# Autodesk Inventor assembly: WAS-PCB
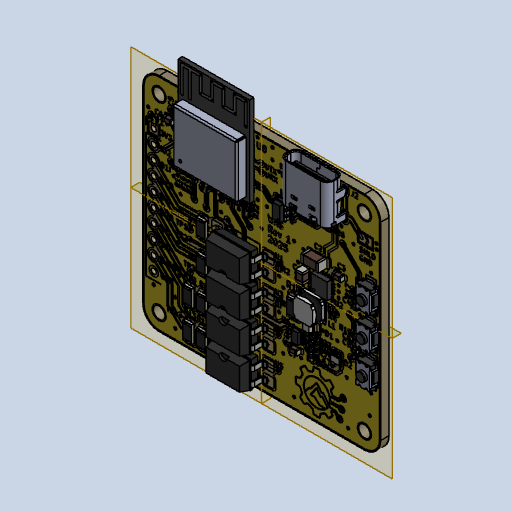
[picture p0: Inventor's stored thumbnail of the model, 512x512]
Saved by Autodesk Inventor 2027.1 (Build 311270010, 270A)
## iProperties
Company: Kicad
Created: 2025-09-30
Part Number: WAS-PCB
Description: KiCad electronic assembly
Document SubType Name: Assembly
Designer: K. Paulsen
Authority: Unknown
Sending System: KiCad to STEP converter
Preprocessor: Open CASCADE STEP processor 7.9
Title: WAS-PCB.step
Author: Pcbnew
## Documents named in this file (23)
- C:\repo\WAS\CAD\WAS-PCB\WAS-PCB\WAS-PCB.iam
- C:\repo\WAS\CAD\WAS-PCB\WAS-PCB\C_1206_3216Metric.ipt
- C:\repo\WAS\CAD\WAS-PCB\WAS-PCB\R_0402_1005Metric.ipt
- C:\repo\WAS\CAD\WAS-PCB\WAS-PCB\TYPE-C-31-M-12.iam
- C:\repo\WAS\CAD\WAS-PCB\WAS-PCB\SMDIP-4_W9.53mm.ipt
- C:\repo\WAS\CAD\WAS-PCB\WAS-PCB\C_0603_1608Metric.ipt
- C:\repo\WAS\CAD\WAS-PCB\WAS-PCB\APTF1616LSEEZGKQBKC.ipt
- C:\repo\WAS\CAD\WAS-PCB\WAS-PCB\TPS62152RGTR.ipt
- C:\repo\WAS\CAD\WAS-PCB\WAS-PCB\ESP32-C3-MINI-1-N4.ipt
- C:\repo\WAS\CAD\WAS-PCB\WAS-PCB\C_0402_1005Metric.ipt
- C:\repo\WAS\CAD\WAS-PCB\WAS-PCB\TS-1088-AR02016.ipt
- C:\repo\WAS\CAD\WAS-PCB\WAS-PCB\R_1206_3216Metric.ipt
- C:\repo\WAS\CAD\WAS-PCB\WAS-PCB\YHNR4020-2R2.ipt
- C:\repo\WAS\CAD\WAS-PCB\WAS-PCB\LED_0805_2012Metric.ipt
- C:\repo\WAS\CAD\WAS-PCB\WAS-PCB\C_0805_2012Metric.ipt
- C:\repo\WAS\CAD\WAS-PCB\WAS-PCB\SOT-583-8.ipt
- C:\repo\WAS\CAD\WAS-PCB\WAS-PCB\SOT-23-6.ipt
- C:\repo\WAS\CAD\WAS-PCB\WAS-PCB\WAS_copper.ipt
- C:\repo\WAS\CAD\WAS-PCB\WAS-PCB\WAS_pad.ipt
- C:\repo\WAS\CAD\WAS-PCB\WAS-PCB\WAS_via.ipt
- C:\repo\WAS\CAD\WAS-PCB\WAS-PCB\WAS_silkscreen.ipt
- C:\repo\WAS\CAD\WAS-PCB\WAS-PCB\WAS_soldermask.ipt
- C:\repo\WAS\CAD\WAS-PCB\WAS-PCB\WAS_PCB.ipt
## Components (57 placed, 57 different names)
1. 1
2. 2
3. 4 [sub-assembly]
4. 5
5. 6
6. 7
7. 8
8. 9
9. 10
10. 11
11. 12
12. 13
13. 14
14. 15
15. 16
16. 17
17. 18
18. 19
19. 20
20. 21
21. 22
22. 23
23. 24
24. 25
25. 26
26. 27
27. 28
28. 29
29. 30
30. 31
31. 32
32. 33
33. 34
34. 35
35. 36
36. 37
37. 38
38. 39
39. 40
40. 41
41. 42
42. 43
43. 44
44. 45
45. 46
46. 47
47. 48
48. 49
49. 50
50. 51
51. 52
52. 53
53. 54
54. 55
55. 56
56. 57 — Flush:3
57. 58 — Flush:1, Flush:2
## Relationships (3: Flush 3)
- Flush:1 (-22 mm): 58
- Flush:2 (-20.5 mm): 58
- Flush:3 (0.006 mm): 57
